# Autodesk Inventor assembly: Ensamblaje_Completo
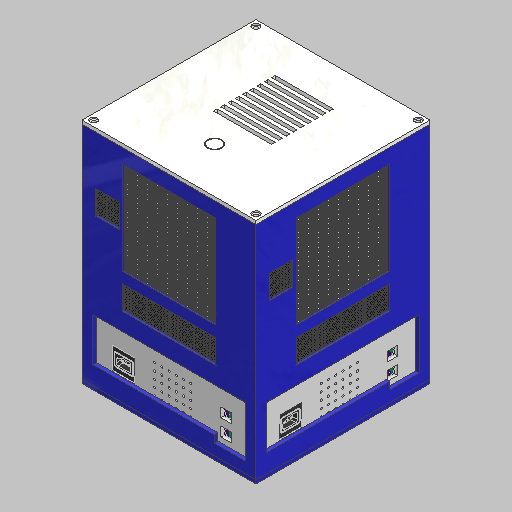
[picture p0: Inventor's stored thumbnail of the model, 512x512]
Saved by Autodesk Inventor 2027 (Build 310192000, 192)
## iProperties
Created: 2026-11-23
Part Number: Ensamblaje_Completo
Document SubType Name: Assembly
Designer: Alexander
Author: Alexander
## Documents named in this file (11)
- C:\Users\Alexander\Documents\Propuesta_Modelo_3D\Propuesta_Modelo_3D\Modelo V2\Ensamblaje_Completo.iam
- C:\Users\Alexander\Documents\Propuesta_Modelo_3D\Propuesta_Modelo_3D\Modelo V2\Carcasa_inferior.ipt
- C:\Users\Alexander\Documents\Propuesta_Modelo_3D\Propuesta_Modelo_3D\Modelo V2\Frontal_Puertos.iam
- C:\Users\Alexander\Documents\Propuesta_Modelo_3D\Propuesta_Modelo_3D\Modelo V2\Armadura_Base_interna.ipt
- C:\Users\Alexander\Documents\Propuesta_Modelo_3D\Propuesta_Modelo_3D\Modelo V2\Armadura_Interna.ipt
- C:\Users\Alexander\Documents\Propuesta_Modelo_3D\Propuesta_Modelo_3D\Modelo V2\Separador.ipt
- C:\Users\Alexander\Documents\Propuesta_Modelo_3D\Propuesta_Modelo_3D\Modelo V2\LedUniatio_Ensamblaje.iam
- C:\Users\Alexander\Documents\Propuesta_Modelo_3D\Propuesta_Modelo_3D\Modelo V2\Armadura_externa.ipt
- C:\Users\Alexander\Documents\Propuesta_Modelo_3D\Propuesta_Modelo_3D\Modelo V2\Armadura_superior.ipt
- C:\Users\Alexander\Documents\Propuesta_Modelo_3D\Propuesta_Modelo_3D\Modelo V2\Modullo_led.iam
- C:\Users\Alexander\Documents\Propuesta_Modelo_3D\Propuesta_Modelo_3D\Modelo V2\LedUnidad.iam
## Components (37 placed, 10 different names)
1. Carcasa_inferior:1 — Insertar:1, Insertar:2, Insertar:3, Insertar:4, Insertar:5, Insertar:6, Insertar:7, Insertar:8, Insertar:43, Insertar:44
2. Frontal_Puertos:1 [sub-assembly] — Insertar:1, Insertar:2, Insertar:15
3. Frontal_Puertos:2 [sub-assembly] — Insertar:3, Insertar:4, Insertar:11, Insertar:12
4. Frontal_Puertos:3 [sub-assembly] — Insertar:5, Insertar:6, Insertar:13, Insertar:14
5. Frontal_Puertos:4 [sub-assembly] — Insertar:7, Insertar:8, Insertar:9, Insertar:10
6. Armadura_Base_interna:1 — Insertar:9, Insertar:10, Insertar:11, Insertar:12, Insertar:13, Insertar:14, Insertar:15, Insertar:16, Insertar:17, Insertar:18
7. Armadura_Interna:1 — Insertar:16, Insertar:17, Insertar:18, Insertar:19, Insertar:20, Insertar:21, Insertar:22, Insertar:23, Insertar:24, Insertar:25, Insertar:26, Insertar:27, Insertar:28, Insertar:29, Insertar:30, Insertar:31, Insertar:32, Insertar:33, Insertar:34, Insertar:45, Insertar:46, Insertar:47, Insertar:48, Insertar:49, Insertar:50, Insertar:51, Insertar:52, Insertar:53, Insertar:54, Insertar:55, Insertar:56
8. Separador:1 — Insertar:21
9. Separador:2 — Insertar:20, Insertar:36
10. Separador:3 — Insertar:22
11. Separador:4 — Insertar:19, Insertar:35
12. Separador:5 — Insertar:23, Insertar:38
13. Separador:6 — Insertar:25
14. Separador:7 — Insertar:26
15. Separador:8 — Insertar:24, Insertar:37
16. Separador:9 — Insertar:29
17. Separador:10 — Insertar:30
18. Separador:11 — Insertar:27, Insertar:42
19. Separador:12 — Insertar:28, Insertar:41
20. Separador:13 — Insertar:31, Insertar:39
21. Separador:14 — Insertar:32, Insertar:40
22. Separador:15 — Insertar:33
23. Separador:16 — Insertar:34
24. LedUniatio_Ensamblaje:1 [sub-assembly] — Insertar:35, Insertar:36
25. LedUniatio_Ensamblaje:2 [sub-assembly] — Insertar:39, Insertar:40
26. LedUniatio_Ensamblaje:3 [sub-assembly] — Insertar:41, Insertar:42
27. LedUniatio_Ensamblaje:4 [sub-assembly] — Insertar:37, Insertar:38
28. Armadura_externa:1 — Insertar:43, Insertar:44, Insertar:57, Insertar:58
29. Armadura_superior:1 — Insertar:57, Insertar:58
30. Modullo_led:1 [sub-assembly] — Insertar:45, Insertar:46
31. Modullo_led:2 [sub-assembly] — Insertar:49, Insertar:50
32. Modullo_led:3 [sub-assembly] — Insertar:51, Insertar:52
33. Modullo_led:4 [sub-assembly] — Insertar:47, Insertar:48
34. LedUnidad:1 [sub-assembly] — Insertar:53
35. LedUnidad:2 [sub-assembly] — Insertar:54
36. LedUnidad:3 [sub-assembly] — Insertar:55
37. LedUnidad:4 [sub-assembly] — Insertar:56
## Relationships (58: Insert 58)
- Insertar:1: Carcasa_inferior:1 ↔ Frontal_Puertos:1
- Insertar:2: Carcasa_inferior:1 ↔ Frontal_Puertos:1
- Insertar:3: Carcasa_inferior:1 ↔ Frontal_Puertos:2
- Insertar:4: Carcasa_inferior:1 ↔ Frontal_Puertos:2
- Insertar:5: Carcasa_inferior:1 ↔ Frontal_Puertos:3
- Insertar:6: Carcasa_inferior:1 ↔ Frontal_Puertos:3
- Insertar:7: Carcasa_inferior:1 ↔ Frontal_Puertos:4
- Insertar:8: Carcasa_inferior:1 ↔ Frontal_Puertos:4
- Insertar:9: Frontal_Puertos:4 ↔ Armadura_Base_interna:1
- Insertar:10: Frontal_Puertos:4 ↔ Armadura_Base_interna:1
- Insertar:11: Frontal_Puertos:2 ↔ Armadura_Base_interna:1
- Insertar:12: Frontal_Puertos:2 ↔ Armadura_Base_interna:1
- Insertar:13: Frontal_Puertos:3 ↔ Armadura_Base_interna:1
- Insertar:14: Frontal_Puertos:3 ↔ Armadura_Base_interna:1
- Insertar:15: Frontal_Puertos:1 ↔ Armadura_Base_interna:1
- Insertar:16: Armadura_Base_interna:1 ↔ Armadura_Interna:1
- Insertar:17: Armadura_Base_interna:1 ↔ Armadura_Interna:1
- Insertar:18: Armadura_Base_interna:1 ↔ Armadura_Interna:1
- Insertar:19: Armadura_Interna:1 ↔ Separador:4
- Insertar:20: Armadura_Interna:1 ↔ Separador:2
- Insertar:21: Armadura_Interna:1 ↔ Separador:1
- Insertar:22: Armadura_Interna:1 ↔ Separador:3
- Insertar:23: Armadura_Interna:1 ↔ Separador:5
- Insertar:24: Armadura_Interna:1 ↔ Separador:8
- Insertar:25: Armadura_Interna:1 ↔ Separador:6
- Insertar:26: Armadura_Interna:1 ↔ Separador:7
- Insertar:27: Armadura_Interna:1 ↔ Separador:11
- Insertar:28: Armadura_Interna:1 ↔ Separador:12
- Insertar:29: Armadura_Interna:1 ↔ Separador:9
- Insertar:30: Armadura_Interna:1 ↔ Separador:10
- Insertar:31: Armadura_Interna:1 ↔ Separador:13
- Insertar:32: Armadura_Interna:1 ↔ Separador:14
- Insertar:33: Armadura_Interna:1 ↔ Separador:15
- Insertar:34: Armadura_Interna:1 ↔ Separador:16
- Insertar:35: Separador:4 ↔ LedUniatio_Ensamblaje:1
- Insertar:36: Separador:2 ↔ LedUniatio_Ensamblaje:1
- Insertar:37: Separador:8 ↔ LedUniatio_Ensamblaje:4
- Insertar:38: Separador:5 ↔ LedUniatio_Ensamblaje:4
- Insertar:39: Separador:13 ↔ LedUniatio_Ensamblaje:2
- Insertar:40: Separador:14 ↔ LedUniatio_Ensamblaje:2
- Insertar:41: Separador:12 ↔ LedUniatio_Ensamblaje:3
- Insertar:42: Separador:11 ↔ LedUniatio_Ensamblaje:3
- Insertar:43: Carcasa_inferior:1 ↔ Armadura_externa:1
- Insertar:44: Carcasa_inferior:1 ↔ Armadura_externa:1
- Insertar:45: Armadura_Interna:1 ↔ Modullo_led:1
- Insertar:46: Armadura_Interna:1 ↔ Modullo_led:1
- Insertar:47: Armadura_Interna:1 ↔ Modullo_led:4
- Insertar:48: Armadura_Interna:1 ↔ Modullo_led:4
- Insertar:49: Armadura_Interna:1 ↔ Modullo_led:2
- Insertar:50: Armadura_Interna:1 ↔ Modullo_led:2
- Insertar:51: Armadura_Interna:1 ↔ Modullo_led:3
- Insertar:52: Armadura_Interna:1 ↔ Modullo_led:3
- Insertar:53: Armadura_Interna:1 ↔ LedUnidad:1
- Insertar:54: Armadura_Interna:1 ↔ LedUnidad:2
- Insertar:55: Armadura_Interna:1 ↔ LedUnidad:3
- Insertar:56: Armadura_Interna:1 ↔ LedUnidad:4
- Insertar:57: Armadura_externa:1 ↔ Armadura_superior:1
- Insertar:58: Armadura_externa:1 ↔ Armadura_superior:1
